# Autodesk Inventor assembly: Landing Gear bawah
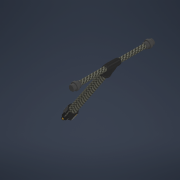
[picture p0: Inventor's stored thumbnail of the model, 180x180]
Saved by Autodesk Inventor 2021 (Build 250183000, 183)
## iProperties
Created: 2021-05-23
Part Number: Landing Gear bawah
Document SubType Name: Assembly
Designer: ACER
Author: ACER
## Documents named in this file (6)
- D:\Experimen\Inventor\BAYUCARAKA\Tarot\Landing Gear bawah\Landing Gear bawah.iam
- D:\Experimen\Inventor\BAYUCARAKA\Tarot\Landing Gear bawah\Lower Tube.ipt
- D:\Experimen\Inventor\BAYUCARAKA\Tarot\Landing Gear bawah\20021-013_landing-gear-foot v1.ipt
- D:\Experimen\Inventor\BAYUCARAKA\Tarot\Landing Gear bawah\20021-011_landing-gear-connector v1.ipt
- D:\Experimen\Inventor\BAYUCARAKA\Tarot\Landing Gear bawah\20021-010_leg v1.ipt
- D:\Experimen\Inventor\BAYUCARAKA\Tarot\Arm Pivot\20021-004_arm-pivot.iam
## Components (6 placed, 5 different names)
1. Lower Tube:1 — Flush:1, Mate:1, Mate:2, Mate:3, Mate:4, Mate:5
2. 20021-013_landing-gear-foot v1:1 — Mate:4, Mate:5
3. 20021-013_landing-gear-foot v1:2 — Mate:2, Mate:3
4. 20021-011_landing-gear-connector v1:1 — Flush:1, Mate:1, Mate:6, Mate:7
5. 20021-010_leg v1:1 — Mate:6, Mate:7, Mate:8, Mate:9, Mate:10
6. 20021-004_arm-pivot:1 [sub-assembly] — Mate:8, Mate:9, Mate:10
## Relationships (11: Mate 10, Flush 1)
- Flush:1 (82.395 mm): Lower Tube:1 ↔ 20021-011_landing-gear-connector v1:1
- Mate:1: Lower Tube:1 ↔ 20021-011_landing-gear-connector v1:1
- Mate:2: Lower Tube:1 ↔ 20021-013_landing-gear-foot v1:2
- Mate:3: Lower Tube:1 ↔ 20021-013_landing-gear-foot v1:2
- Mate:4: Lower Tube:1 ↔ 20021-013_landing-gear-foot v1:1
- Mate:5: Lower Tube:1 ↔ 20021-013_landing-gear-foot v1:1
- Mate:6 (-20 mm): 20021-011_landing-gear-connector v1:1 ↔ 20021-010_leg v1:1
- Mate:7: 20021-011_landing-gear-connector v1:1 ↔ 20021-010_leg v1:1
- Mate:8: 20021-010_leg v1:1 ↔ 20021-004_arm-pivot:1
- Mate:9: 20021-010_leg v1:1 ↔ 20021-004_arm-pivot:1
- Mate:10: 20021-010_leg v1:1 ↔ 20021-004_arm-pivot:1
